# Autodesk Inventor assembly: Support_servomot
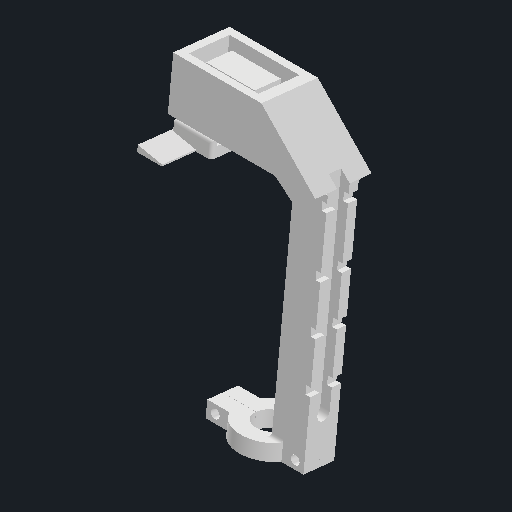
[picture p0: Inventor's stored thumbnail of the model, 512x512]
Saved by Autodesk Inventor 2026 (Build 300175000, 175)
## iProperties
Created: 2025-06-08
Part Number: Support_servomot
Document SubType Name: Assembly
Designer: Diogo
Author: Diogo
## Documents named in this file (5)
- C:\Users\remg9\OneDrive - HESSO\P2511_Dossier_partage_RVEZ\01_Robot\0101_CAO\2_Stabil\Support_servomot.iam
- C:\Users\remg9\OneDrive - HESSO\P2511_Dossier_partage_RVEZ\01_Robot\0101_CAO\2_Stabil\2_06_Support_servomot.ipt
- C:\Users\remg9\OneDrive - HESSO\P2511_Dossier_partage_RVEZ\01_Robot\0101_CAO\2_Stabil\2_07_attache_support_servomot.ipt
- C:\Users\remg9\OneDrive - HESSO\P2511_Dossier_partage_RVEZ\01_Robot\0101_CAO\2_Stabil\servomot.ipt
- C:\Users\remg9\OneDrive - HESSO\P2511_Dossier_partage_RVEZ\01_Robot\0101_CAO\2_Stabil\2_10_plaque_servomotv2.ipt
## Components (4 placed, 4 different names)
1. 2_06_Support_servomot:1 — Mate:1, Mate:2, Mate:3, Mate:4, Mate:5, Mate:6
2. 2_07_attache_support_servomot:1 — Mate:1, Mate:2, Mate:3
3. servomot:1 — Mate:4, Mate:5, Mate:6, Mate:7
4. 2_10_plaque_servomotv2:1 — Mate:7
## Relationships (7: Mate 7)
- Mate:1: 2_06_Support_servomot:1 ↔ 2_07_attache_support_servomot:1
- Mate:2: 2_06_Support_servomot:1 ↔ 2_07_attache_support_servomot:1
- Mate:3: 2_06_Support_servomot:1 ↔ 2_07_attache_support_servomot:1
- Mate:4: 2_06_Support_servomot:1 ↔ servomot:1
- Mate:5: 2_06_Support_servomot:1 ↔ servomot:1
- Mate:6: 2_06_Support_servomot:1 ↔ servomot:1
- Mate:7: servomot:1 ↔ 2_10_plaque_servomotv2:1
